# Autodesk Inventor assembly: RD37-FR5-V6.0Èí¼þÄ£ÐÍ
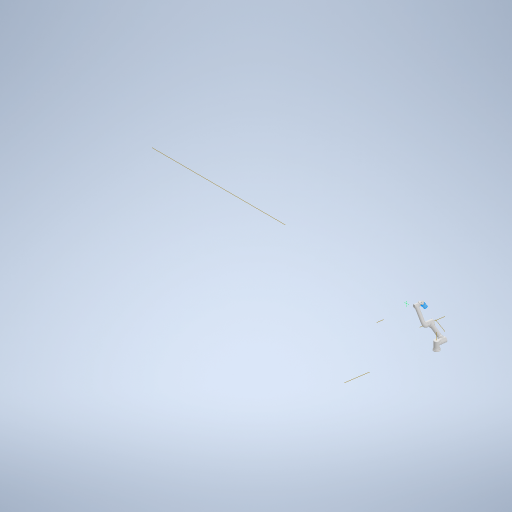
[picture p0: Inventor's stored thumbnail of the model, 512x512]
Saved by Autodesk Inventor 2024.2 (Build 282272000, 272)
## iProperties
Created: 2024-11-14
Part Number: RD37-FR5-V6.0Èí¼þÄ£ÐÍ
Description: STEP AP203
Document SubType Name: Assembly
Designer: liama
Sending System: SolidWorks 2018
Preprocessor: SwSTEP 2.0
Title: RD37-FR5-V6.0Èí¼þÄ£ÐÍ.STEP
Revision Number: ÈÎºÎ
## Documents named in this file (9)
- C:\Users\liama\OneDrive\Documents\School\Senior Design\Git\XRayBotics\FRCobots-V6.0 STEP Models\FRCobots-V6.0 STEP Models\FR5-V6.0 Model\FR5-V6.0 Model.iam
- C:\Users\liama\OneDrive\Documents\School\Senior Design\Git\XRayBotics\FRCobots-V6.0 STEP Models\FRCobots-V6.0 STEP Models\FR5-V6.0 Model\RD37-FR5-V6.0-1.ipt
- C:\Users\liama\OneDrive\Documents\School\Senior Design\Git\XRayBotics\FRCobots-V6.0 STEP Models\FRCobots-V6.0 STEP Models\FR5-V6.0 Model\RD37-FR5-V6.0-2.ipt
- C:\Users\liama\OneDrive\Documents\School\Senior Design\Git\XRayBotics\FRCobots-V6.0 STEP Models\FRCobots-V6.0 STEP Models\FR5-V6.0 Model\RD37-FR5-V6.0-3.ipt
- C:\Users\liama\OneDrive\Documents\School\Senior Design\Git\XRayBotics\FRCobots-V6.0 STEP Models\FRCobots-V6.0 STEP Models\FR5-V6.0 Model\RD37-FR5-V6.0-4.ipt
- C:\Users\liama\OneDrive\Documents\School\Senior Design\Git\XRayBotics\FRCobots-V6.0 STEP Models\FRCobots-V6.0 STEP Models\FR5-V6.0 Model\RD37-FR5-V6.0-5.ipt
- C:\Users\liama\OneDrive\Documents\School\Senior Design\Git\XRayBotics\FRCobots-V6.0 STEP Models\FRCobots-V6.0 STEP Models\FR5-V6.0 Model\RD37-FR5-V6.0-6.ipt
- C:\Users\liama\OneDrive\Documents\School\Senior Design\Git\XRayBotics\FRCobots-V6.0 STEP Models\FRCobots-V6.0 STEP Models\FR5-V6.0 Model\RD37-FR5-V6.0-7.ipt
- C:\Users\liama\OneDrive\Documents\3D print\8-9\Part1.ipt
## Components (8 placed, 8 different names)
1. RD37-FR5-V6.0-1_1 — Rotational:1
2. RD37-FR5-V6.0-2_2 — Rotational:1, Rotational:2, Mate:4
3. RD37-FR5-V6.0-3_3 — Rotational:2, Rotational:3, Flush:1, Mate:2, Mate:3
4. RD37-FR5-V6.0-4_4 — Rotational:3, Rotational:4, Flush:1, Mate:1
5. RD37-FR5-V6.0-5_5 — Rotational:4, Rotational:5, Mate:5
6. RD37-FR5-V6.0-6_6 — Rotational:5, Rotational:6, Mate:6
7. RD37-FR5-V6.0-7_7 — Rotational:6, Ball:1
8. Part1:1 — Ball:1
## Relationships (14: RevoluteJoint 6, Mate 6, Flush 1, BallJoint 1)
- Rotational:1 [RevoluteJoint]: RD37-FR5-V6.0-1_1 ↔ RD37-FR5-V6.0-2_2
- Rotational:2 [RevoluteJoint]: RD37-FR5-V6.0-2_2 ↔ RD37-FR5-V6.0-3_3
- Rotational:3 [RevoluteJoint]: RD37-FR5-V6.0-3_3 ↔ RD37-FR5-V6.0-4_4
- Rotational:4 [RevoluteJoint]: RD37-FR5-V6.0-4_4 ↔ RD37-FR5-V6.0-5_5
- Rotational:5 [RevoluteJoint]: RD37-FR5-V6.0-5_5 ↔ RD37-FR5-V6.0-6_6
- Rotational:6 [RevoluteJoint]: RD37-FR5-V6.0-6_6 ↔ RD37-FR5-V6.0-7_7
- Flush:1: RD37-FR5-V6.0-3_3 ↔ RD37-FR5-V6.0-4_4
- Ball:1: RD37-FR5-V6.0-7_7 ↔ Part1:1
- Mate:1: RD37-FR5-V6.0-4_4
- Mate:2: RD37-FR5-V6.0-3_3
- Mate:3: RD37-FR5-V6.0-3_3
- Mate:4: RD37-FR5-V6.0-2_2
- Mate:5: RD37-FR5-V6.0-5_5
- Mate:6: RD37-FR5-V6.0-6_6
